# Autodesk Inventor assembly: MN0555AN106_G09_001
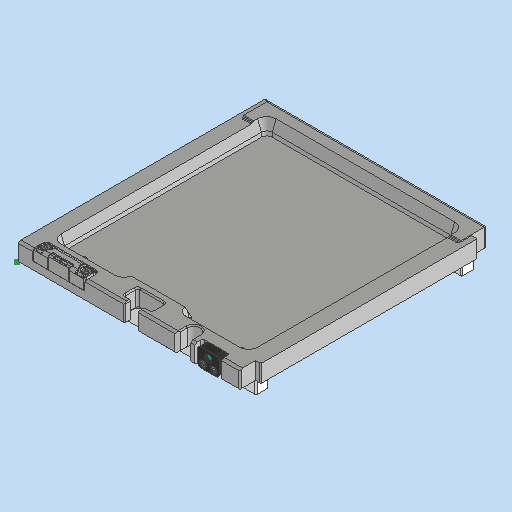
[picture p0: Inventor's stored thumbnail of the model, 512x512]
Saved by Autodesk Inventor 2023.3 (Build 273359000, 359)
## iProperties
RuleStatus: InUse
Created: 2023-01-03
Part Number: MN0555AN106_G09_001
Description: =<RBPARTNOTITLE2>
Document SubType Name: Assembly
Designer: ric7an
Mass: 3203.89 g
Surface Area: 1552.89 cm^2
Volume: 484.164 cm^3
Density: 6.61735 g/cm^3
AnP_Kategorie: 99
AnP_Material: =<Material>
AnP_TemplVers: 20200821
RBDOCUMENTTYPE: DRF
RBDOCUMENTVERSION: 00
RBDRAWINGMAINSCALE: 1:1
RBDRAWINGMISSINGSPEC: --
RBDRAWINGVOLUME: --
RBDSV1: 0850
RBGBEDGESIN1: +0,5
RBGBEDGESIN2: +0,2
RBGBEDGESOUT1: -0,3
RBGBEDGESOUT2: -0,1
RBMATERIAL: =<Material>
RBMATMEETS: --
RBMATNO: =<Part Number>
RBPARTMADEOF: --
RBPARTNO: SIEHE MNR
RBPARTNOTITLE1: Locking mask
RBPARTNOTITLE2: Verschlussmaske
RBPARTSAFETYINDICATOR: --
RBSURFACE: --
RBSURFACE2: --
RBZEDGESNORM: ISO13715:2002-06
RBZGENDIMCLASS: m
RBZGENDIMNORM: ISO 2768-1:1989-11
RBZGENGEOCLASS: H
RBZGENGEONORM: ISO 2768-2:1989-11
RBZSURFACENORM: ISO13D2:2002-02
RBZTOLERANCENORM: ISO 14405-1:2010-12
Author: ric7an
Keywords: =<RBPARTMADEOF>
Comments: =<RBSURFACE2>
Revision Number: 01
## Documents named in this file (11)
- C:\Users\rea9an\Documents\Inventor\TCAI2412_te1910_EM\AS00000977.iam
- C:\Users\rea9an\Documents\Inventor\TCAI2412_te1910_EM\PT00004402.ipt
- C:\Users\rea9an\Documents\Inventor\TCAI2412_te1910_EM\PT00004397.ipt
- C:\Users\rea9an\Documents\Inventor\TCAI2412_te1910_EM\PT00004842.ipt
- C:\Users\rea9an\Documents\Inventor\TCAI2412_te1910_EM\PT00004766.ipt
- C:\Users\rea9an\Documents\Inventor\TCAI2412_te1910_EM\PT00004865.ipt
- C:\Users\rea9an\Documents\Inventor\TCAI2412_te1910_EM\PT00004879.ipt
- C:\Users\rea9an\Documents\Inventor\TCAI2412_te1910_EM\PT00004767.ipt
- C:\Users\rea9an\Documents\Inventor\TCAI2412_te1910_EM\PT00004839.ipt
- C:\Users\rea9an\Documents\Inventor\TCAI2412_te1910_EM\PT00004768.ipt
- C:\Users\rea9an\Documents\Inventor\TCAI2412_te1910_EM\PT00004769.ipt
## Components (17 placed, 10 different names)
1. PT00004768:1 — Einfügen:2, Einfügen:3, Einfügen:10, Einfügen:11, Einfügen:20, Passend:1, Einfügen:21, Passend:2, Einfügen:24, Passend:3
2. PT00004769:1 — Einfügen:10, Einfügen:6, Einfügen:7, Einfügen:11
3. PT00004769:2 — Einfügen:24, Passend:3
4. PT00004766:1 — Einfügen:17, Einfügen:18, Einfügen:19, Einfügen:20, Passend:1
5. PT00004767:1 — Einfügen:21, Passend:2, Einfügen:22, Einfügen:23
6. PT00004839:1 — Einfügen:23
7. PT00004839:2 — Einfügen:22
8. PT00004879:1
9. PT00004879:2
10. PT00004865:1 — Einfügen:17
11. PT00004865:3 — Einfügen:18
12. PT00004879:3 — Einfügen:6
13. PT00004879:4 — Einfügen:7
14. PT00004842:1 — Einfügen:8
15. PT00004842:2 — Einfügen:9
16. PT00004397:1 — Einfügen:2, Einfügen:3, Einfügen:8, Einfügen:9
17. PT00004402:1 — Einfügen:19
## Relationships (21: Insert 18, Mate 3)
- Einfügen:2 [Insert]: PT00004768:1 ↔ PT00004397:1
- Einfügen:3 [Insert]: PT00004768:1 ↔ PT00004397:1
- Einfügen:10 [Insert]: PT00004768:1 ↔ PT00004769:1
- Einfügen:6 [Insert]: PT00004769:1 ↔ PT00004879:3
- Einfügen:7 [Insert]: PT00004769:1 ↔ PT00004879:4
- Einfügen:8 [Insert]: PT00004842:1 ↔ PT00004397:1
- Einfügen:9 [Insert]: PT00004842:2 ↔ PT00004397:1
- Einfügen:11 [Insert]: PT00004768:1 ↔ PT00004769:1
- [Insert]: PT00004769:2 ↔ PT00004879:2
- [Insert]: PT00004769:2 ↔ PT00004879:1
- Einfügen:17 [Insert]: PT00004766:1 ↔ PT00004865:1
- Einfügen:18 [Insert]: PT00004766:1 ↔ PT00004865:3
- Einfügen:19 [Insert]: PT00004766:1 ↔ PT00004402:1
- Einfügen:20 [Insert]: PT00004768:1 ↔ PT00004766:1
- Passend:1 [Mate]: PT00004768:1 ↔ PT00004766:1
- Einfügen:21 [Insert]: PT00004768:1 ↔ PT00004767:1
- Passend:2 [Mate]: PT00004768:1 ↔ PT00004767:1
- Einfügen:22 [Insert]: PT00004767:1 ↔ PT00004839:2
- Einfügen:23 [Insert]: PT00004767:1 ↔ PT00004839:1
- Einfügen:24 [Insert]: PT00004768:1 ↔ PT00004769:2
- Passend:3 [Mate]: PT00004768:1 ↔ PT00004769:2
## Named parameters: d26_d20 = 0 mm, d27_d21 = 0 mm
